# Autodesk Inventor assembly: Chapa lateral perfil
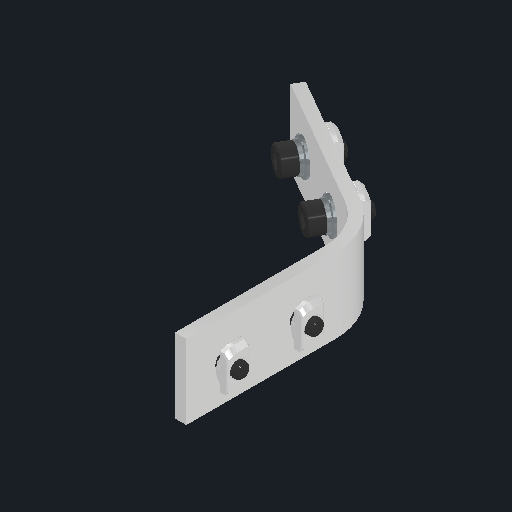
[picture p0: Inventor's stored thumbnail of the model, 512x512]
Saved by Autodesk Inventor 2026.1 (Build 301233000, 233)
## iProperties
Created: 2025-02-18
Part Number: Chapa lateral perfil
Document SubType Name: Assembly
Designer: Cliente
Mass: 28.4906 g
Surface Area: 77.911 cm^2
Volume: 7.33769 cm^3
Density: 3.88277 g/cm^3
Author: Cliente
## Documents named in this file (6)
- C:\Users\Cliente\Desktop\TCC\Fixação\Chapa lateral perfil.iam
- C:\Users\Cliente\Desktop\TCC\Base\Alumínio\Chapa lateral perfil.ipt
- C:\Users\Cliente\Desktop\TCC\Fixação\Porca martelo M4 canal 6.ipt
- C:\Users\Cliente\Desktop\TCC\Fixação\Arruela Lisa DIN 125 - B4 - 300 HV.ipt
- C:\Users\Cliente\Desktop\TCC\Fixação\Arruela de Pressão DIN 127 - B4.ipt
- C:\Users\Cliente\Desktop\TCC\Fixação\Parafuso Allen Cabeça Cilíndrica DIN 912 - M4 - 12.9.ipt
## Components (17 placed, 5 different names)
1. Chapa lateral perfil:1 — Alinhado:1, Alinhado:2, Alinhado:3, Coincidente:25, Coincidente:26, Coincidente:27, Coincidente:28, Ângulo:13, Ângulo:14, Ângulo:15, Ângulo:16, Coincidente:29, Coincidente:30, Coincidente:31, Coincidente:32, Coincidente:33, Coincidente:34, Coincidente:35, Coincidente:36, Coincidente:37, Coincidente:38, Coincidente:39, Coincidente:40
2. Porca martelo M4 canal 6:1 — Coincidente:25, Ângulo:15, Coincidente:37
3. Porca martelo M4 canal 6:2 — Coincidente:26, Ângulo:16, Coincidente:38
4. Porca martelo M4 canal 6:3 — Coincidente:27, Ângulo:14, Coincidente:39
5. Porca martelo M4 canal 6:4 — Coincidente:28, Ângulo:13, Coincidente:40
6. Arruela Lisa DIN 125 - B4 - 300 HV:1 — Coincidente:29, Coincidente:33, Ângulo:17, Coincidente:41, Coincidente:45
7. Arruela Lisa DIN 125 - B4 - 300 HV:2 — Coincidente:30, Coincidente:34, Ângulo:18, Coincidente:42, Coincidente:46
8. Arruela Lisa DIN 125 - B4 - 300 HV:3 — Coincidente:31, Coincidente:35, Ângulo:19, Coincidente:43, Coincidente:47
9. Arruela Lisa DIN 125 - B4 - 300 HV:4 — Coincidente:32, Coincidente:36, Ângulo:20, Coincidente:44, Coincidente:48
10. Arruela de Pressão DIN 127 - B4:1 — Coincidente:41, Coincidente:45, Ângulo:21, Coincidente:49, Coincidente:56
11. Arruela de Pressão DIN 127 - B4:2 — Coincidente:42, Coincidente:46, Ângulo:22, Coincidente:50, Coincidente:55
12. Arruela de Pressão DIN 127 - B4:3 — Coincidente:43, Coincidente:47, Ângulo:23, Coincidente:51, Coincidente:54
13. Arruela de Pressão DIN 127 - B4:4 — Coincidente:44, Coincidente:48, Ângulo:24, Coincidente:52, Coincidente:53
14. Parafuso Allen Cabeça Cilíndrica DIN 912 - M4 - 12.9:1 — Coincidente:49, Coincidente:56, Ângulo:25
15. Parafuso Allen Cabeça Cilíndrica DIN 912 - M4 - 12.9:2 — Coincidente:50, Coincidente:55, Ângulo:26
16. Parafuso Allen Cabeça Cilíndrica DIN 912 - M4 - 12.9:3 — Coincidente:51, Coincidente:54, Ângulo:27
17. Parafuso Allen Cabeça Cilíndrica DIN 912 - M4 - 12.9:4 — Coincidente:52, Coincidente:53, Ângulo:28
## Relationships (51: Mate 32, Angle 16, Flush 3)
- Alinhado:1 [Flush]: Chapa lateral perfil:1
- Alinhado:2 [Flush]: Chapa lateral perfil:1
- Alinhado:3 [Flush]: Chapa lateral perfil:1
- Coincidente:25 [Mate] (1.8 mm): Chapa lateral perfil:1 ↔ Porca martelo M4 canal 6:1
- Coincidente:26 [Mate] (1.8 mm): Chapa lateral perfil:1 ↔ Porca martelo M4 canal 6:2
- Coincidente:27 [Mate] (1.8 mm): Chapa lateral perfil:1 ↔ Porca martelo M4 canal 6:3
- Coincidente:28 [Mate] (1.8 mm): Chapa lateral perfil:1 ↔ Porca martelo M4 canal 6:4
- Ângulo:13 [Angle] (0 deg): Chapa lateral perfil:1 ↔ Porca martelo M4 canal 6:4
- Ângulo:14 [Angle] (0 deg): Chapa lateral perfil:1 ↔ Porca martelo M4 canal 6:3
- Ângulo:15 [Angle] (0 deg): Chapa lateral perfil:1 ↔ Porca martelo M4 canal 6:1
- Ângulo:16 [Angle] (0 deg): Chapa lateral perfil:1 ↔ Porca martelo M4 canal 6:2
- Coincidente:29 [Mate]: Chapa lateral perfil:1 ↔ Arruela Lisa DIN 125 - B4 - 300 HV:1
- Coincidente:30 [Mate]: Chapa lateral perfil:1 ↔ Arruela Lisa DIN 125 - B4 - 300 HV:2
- Coincidente:31 [Mate]: Chapa lateral perfil:1 ↔ Arruela Lisa DIN 125 - B4 - 300 HV:3
- Coincidente:32 [Mate]: Chapa lateral perfil:1 ↔ Arruela Lisa DIN 125 - B4 - 300 HV:4
- Coincidente:33 [Mate]: Chapa lateral perfil:1 ↔ Arruela Lisa DIN 125 - B4 - 300 HV:1
- Coincidente:34 [Mate]: Chapa lateral perfil:1 ↔ Arruela Lisa DIN 125 - B4 - 300 HV:2
- Coincidente:35 [Mate]: Chapa lateral perfil:1 ↔ Arruela Lisa DIN 125 - B4 - 300 HV:3
- Coincidente:36 [Mate]: Chapa lateral perfil:1 ↔ Arruela Lisa DIN 125 - B4 - 300 HV:4
- Coincidente:37 [Mate]: Chapa lateral perfil:1 ↔ Porca martelo M4 canal 6:1
- Coincidente:38 [Mate]: Chapa lateral perfil:1 ↔ Porca martelo M4 canal 6:2
- Coincidente:39 [Mate]: Chapa lateral perfil:1 ↔ Porca martelo M4 canal 6:3
- Coincidente:40 [Mate]: Chapa lateral perfil:1 ↔ Porca martelo M4 canal 6:4
- Ângulo:17 [Angle] (0 deg): Arruela Lisa DIN 125 - B4 - 300 HV:1
- Ângulo:18 [Angle] (0 deg): Arruela Lisa DIN 125 - B4 - 300 HV:2
- Ângulo:19 [Angle] (0 deg): Arruela Lisa DIN 125 - B4 - 300 HV:3
- Ângulo:20 [Angle] (0 deg): Arruela Lisa DIN 125 - B4 - 300 HV:4
- Coincidente:41 [Mate]: Arruela Lisa DIN 125 - B4 - 300 HV:1 ↔ Arruela de Pressão DIN 127 - B4:1
- Coincidente:42 [Mate]: Arruela Lisa DIN 125 - B4 - 300 HV:2 ↔ Arruela de Pressão DIN 127 - B4:2
- Coincidente:43 [Mate]: Arruela Lisa DIN 125 - B4 - 300 HV:3 ↔ Arruela de Pressão DIN 127 - B4:3
- Coincidente:44 [Mate]: Arruela Lisa DIN 125 - B4 - 300 HV:4 ↔ Arruela de Pressão DIN 127 - B4:4
- Coincidente:45 [Mate]: Arruela Lisa DIN 125 - B4 - 300 HV:1 ↔ Arruela de Pressão DIN 127 - B4:1
- Coincidente:46 [Mate]: Arruela Lisa DIN 125 - B4 - 300 HV:2 ↔ Arruela de Pressão DIN 127 - B4:2
- Coincidente:47 [Mate]: Arruela Lisa DIN 125 - B4 - 300 HV:3 ↔ Arruela de Pressão DIN 127 - B4:3
- Coincidente:48 [Mate]: Arruela Lisa DIN 125 - B4 - 300 HV:4 ↔ Arruela de Pressão DIN 127 - B4:4
- Ângulo:21 [Angle] (180 deg): Arruela de Pressão DIN 127 - B4:1
- Ângulo:22 [Angle] (180 deg): Arruela de Pressão DIN 127 - B4:2
- Ângulo:23 [Angle] (180 deg): Arruela de Pressão DIN 127 - B4:3
- Ângulo:24 [Angle] (180 deg): Arruela de Pressão DIN 127 - B4:4
- Coincidente:49 [Mate]: Arruela de Pressão DIN 127 - B4:1 ↔ Parafuso Allen Cabeça Cilíndrica DIN 912 - M4 - 12.9:1
- Coincidente:50 [Mate]: Arruela de Pressão DIN 127 - B4:2 ↔ Parafuso Allen Cabeça Cilíndrica DIN 912 - M4 - 12.9:2
- Coincidente:51 [Mate]: Arruela de Pressão DIN 127 - B4:3 ↔ Parafuso Allen Cabeça Cilíndrica DIN 912 - M4 - 12.9:3
- Coincidente:52 [Mate]: Arruela de Pressão DIN 127 - B4:4 ↔ Parafuso Allen Cabeça Cilíndrica DIN 912 - M4 - 12.9:4
- Coincidente:53 [Mate]: Arruela de Pressão DIN 127 - B4:4 ↔ Parafuso Allen Cabeça Cilíndrica DIN 912 - M4 - 12.9:4
- Coincidente:54 [Mate]: Arruela de Pressão DIN 127 - B4:3 ↔ Parafuso Allen Cabeça Cilíndrica DIN 912 - M4 - 12.9:3
- Coincidente:55 [Mate]: Arruela de Pressão DIN 127 - B4:2 ↔ Parafuso Allen Cabeça Cilíndrica DIN 912 - M4 - 12.9:2
- Coincidente:56 [Mate]: Arruela de Pressão DIN 127 - B4:1 ↔ Parafuso Allen Cabeça Cilíndrica DIN 912 - M4 - 12.9:1
- Ângulo:25 [Angle] (0 deg): Parafuso Allen Cabeça Cilíndrica DIN 912 - M4 - 12.9:1
- Ângulo:26 [Angle] (0 deg): Parafuso Allen Cabeça Cilíndrica DIN 912 - M4 - 12.9:2
- Ângulo:27 [Angle] (0 deg): Parafuso Allen Cabeça Cilíndrica DIN 912 - M4 - 12.9:3
- Ângulo:28 [Angle] (0 deg): Parafuso Allen Cabeça Cilíndrica DIN 912 - M4 - 12.9:4
